# Autodesk Inventor assembly: sertar_inferior_trepte_assmbly
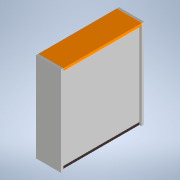
[picture p0: Inventor's stored thumbnail of the model, 180x180]
Saved by Autodesk Inventor 2022.6 (Build 266554000, 554)
## iProperties
RuleStatus: InUse
Created: 2026-10-31
Part Number: sertar_inferior_trepte_assmbly
Document SubType Name: Assembly
Designer: Dragos Macovei
Author: Dragos Macovei
## Documents named in this file (5)
- C:\Users\Dragos Macovei\Documents\3D_Parts\PAT ADI\sertar_inferior_trepte_assmbly.iam
- C:\Users\Dragos Macovei\Documents\3D_Parts\PAT ADI\laterala_sertar_inferior_trepte.ipt
- C:\Users\Dragos Macovei\Documents\3D_Parts\PAT ADI\fata_sertar_inferior_trepte.ipt
- C:\Users\Dragos Macovei\Documents\3D_Parts\PAT ADI\fund_sertar_inferior_trepte.ipt
- C:\Users\Dragos Macovei\Documents\3D_Parts\PAT ADI\spatele_sertar_inferior_trepte.ipt
## Components (5 placed, 4 different names)
1. laterala_sertar_inferior_trepte:1 — Mate:1, Flush:1, Flush:3, Flush:5, Mate:4
2. laterala_sertar_inferior_trepte:2 — Flush:2, Flush:4, Mate:2, Mate:6, Flush:6, Flush:7
3. fata_sertar_inferior_trepte:1 — Mate:1, Flush:1, Flush:2, Flush:3, Flush:4, Mate:2, Mate:3
4. fund_sertar_inferior_trepte:1 — Flush:5, Mate:3, Mate:4, Mate:5
5. spatele_sertar_inferior_trepte:1 — Mate:5, Mate:6, Flush:6, Flush:7
## Relationships (13: Flush 7, Mate 6)
- Mate:1: laterala_sertar_inferior_trepte:1 ↔ fata_sertar_inferior_trepte:1
- Flush:1: laterala_sertar_inferior_trepte:1 ↔ fata_sertar_inferior_trepte:1
- Flush:2: laterala_sertar_inferior_trepte:2 ↔ fata_sertar_inferior_trepte:1
- Flush:3: laterala_sertar_inferior_trepte:1 ↔ fata_sertar_inferior_trepte:1
- Flush:4: laterala_sertar_inferior_trepte:2 ↔ fata_sertar_inferior_trepte:1
- Mate:2: laterala_sertar_inferior_trepte:2 ↔ fata_sertar_inferior_trepte:1
- Flush:5 (15 mm): laterala_sertar_inferior_trepte:1 ↔ fund_sertar_inferior_trepte:1
- Mate:3: fata_sertar_inferior_trepte:1 ↔ fund_sertar_inferior_trepte:1
- Mate:4: laterala_sertar_inferior_trepte:1 ↔ fund_sertar_inferior_trepte:1
- Mate:5: fund_sertar_inferior_trepte:1 ↔ spatele_sertar_inferior_trepte:1
- Mate:6: laterala_sertar_inferior_trepte:2 ↔ spatele_sertar_inferior_trepte:1
- Flush:6: laterala_sertar_inferior_trepte:2 ↔ spatele_sertar_inferior_trepte:1
- Flush:7: laterala_sertar_inferior_trepte:2 ↔ spatele_sertar_inferior_trepte:1
